# Autodesk Inventor assembly: Assembly1
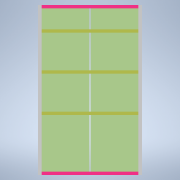
[picture p0: Inventor's stored thumbnail of the model, 180x180]
Saved by Autodesk Inventor 2022.6 (Build 266554000, 554)
## iProperties
Created: 2025-06-19
Part Number: Assembly1
Document SubType Name: Assembly
Designer: Dragos Macovei
Author: Dragos Macovei
## Documents named in this file (6)
- C:\Users\Dragos Macovei\Documents\Inventor_3d_parts\Draghie\baie\Assembly1.iam
- C:\Users\Dragos Macovei\Documents\Inventor_3d_parts\Draghie\baie\fund_capac_corp_baie.ipt
- C:\Users\Dragos Macovei\Documents\Inventor_3d_parts\Draghie\baie\laterala_corp_baie.ipt
- C:\Users\Dragos Macovei\Documents\Inventor_3d_parts\Draghie\baie\usa.ipt
- C:\Users\Dragos Macovei\Documents\Inventor_3d_parts\Draghie\baie\polita.ipt
- C:\Users\Dragos Macovei\Documents\Inventor_3d_parts\Draghie\baie\pfl.ipt
## Components (10 placed, 5 different names)
1. fund_capac_corp_baie:1 — Mate:2, Flush:1, Flush:2, Flush:7, Flush:9, Flush:15
2. fund_capac_corp_baie:2 — Mate:1, Flush:3, Mate:3, Flush:4, Flush:5, Flush:6, Mate:9
3. laterala_corp_baie:1 — Mate:3, Flush:4, Flush:5, Mate:4, Flush:8, Flush:11, Mate:6, Mate:7, Mate:8, Flush:12, Flush:13, Flush:14
4. laterala_corp_baie:2 — Mate:1, Mate:2, Flush:1, Flush:2, Flush:3, Flush:6, Mate:5, Flush:10, Mate:12, Flush:16
5. usa:1 — Mate:4, Flush:7, Flush:8, Flush:11
6. usa:2 — Mate:5, Flush:9, Flush:10
7. polita:1 — Mate:8, Flush:14, Mate:11
8. polita:2 — Mate:7, Flush:13, Mate:10, Mate:11
9. polita:3 — Mate:6, Flush:12, Mate:9, Mate:10
10. pfl:1 — Mate:12, Flush:15, Flush:16
## Relationships (28: Flush 16, Mate 12)
- Mate:1: fund_capac_corp_baie:2 ↔ laterala_corp_baie:2
- Mate:2: fund_capac_corp_baie:1 ↔ laterala_corp_baie:2
- Flush:1: fund_capac_corp_baie:1 ↔ laterala_corp_baie:2
- Flush:2: fund_capac_corp_baie:1 ↔ laterala_corp_baie:2
- Flush:3: fund_capac_corp_baie:2 ↔ laterala_corp_baie:2
- Mate:3: fund_capac_corp_baie:2 ↔ laterala_corp_baie:1
- Flush:4: fund_capac_corp_baie:2 ↔ laterala_corp_baie:1
- Flush:5: fund_capac_corp_baie:2 ↔ laterala_corp_baie:1
- Flush:6: fund_capac_corp_baie:2 ↔ laterala_corp_baie:2
- Mate:4: laterala_corp_baie:1 ↔ usa:1
- Flush:7: fund_capac_corp_baie:1 ↔ usa:1
- Flush:8: laterala_corp_baie:1 ↔ usa:1
- Mate:5: laterala_corp_baie:2 ↔ usa:2
- Flush:9: fund_capac_corp_baie:1 ↔ usa:2
- Flush:10: laterala_corp_baie:2 ↔ usa:2
- Flush:11: laterala_corp_baie:1 ↔ usa:1
- Mate:6: laterala_corp_baie:1 ↔ polita:3
- Mate:7: laterala_corp_baie:1 ↔ polita:2
- Mate:8: laterala_corp_baie:1 ↔ polita:1
- Flush:12: laterala_corp_baie:1 ↔ polita:3
- Flush:13: laterala_corp_baie:1 ↔ polita:2
- Flush:14: laterala_corp_baie:1 ↔ polita:1
- Mate:9 (300 mm): fund_capac_corp_baie:2 ↔ polita:3
- Mate:10 (200 mm): polita:2 ↔ polita:3
- Mate:11 (200 mm): polita:1 ↔ polita:2
- Mate:12: laterala_corp_baie:2 ↔ pfl:1
- Flush:15: fund_capac_corp_baie:1 ↔ pfl:1
- Flush:16: laterala_corp_baie:2 ↔ pfl:1
